# Autodesk Inventor assembly: Anschweißlasche
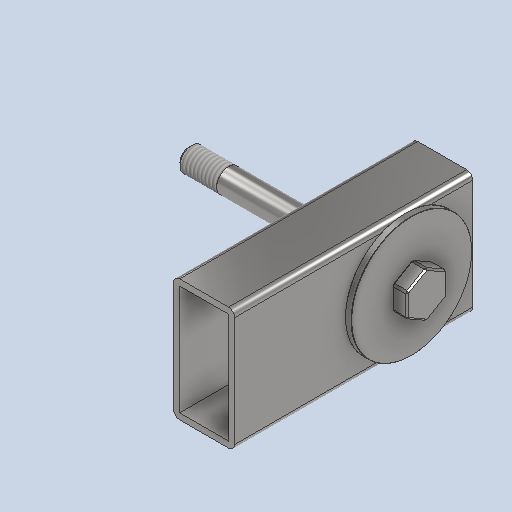
[picture p0: Inventor's stored thumbnail of the model, 512x512]
Saved by Autodesk Inventor 2026.2 (Build 302298010, 298A)
## iProperties
Created: 2026-07-28
Part Number: Anschweißlasche
Document SubType Name: Assembly
Designer: moest
Author: moest
## Documents named in this file (4)
- C:\Users\moest\Downloads\Anschweißlasche.iam
- C:\Users\moest\Downloads\Anschweißlasche Schraube M8.ipt
- C:\Users\moest\Downloads\Anschweißlasche.ipt
- C:\Users\moest\Downloads\Anschweißlasche Scheibe.ipt
## Components (3 placed, 3 different names)
1. Anschweißlasche Schraube M8:1 — Passend:3, Passend:4
2. Anschweißlasche:1 — Passend:1, Passend:2, Passend:3
3. Anschweißlasche Scheibe:1 — Passend:1, Passend:2, Passend:4
## Relationships (4: Mate 4)
- Passend:1 [Mate]: Anschweißlasche:1 ↔ Anschweißlasche Scheibe:1
- Passend:2 [Mate]: Anschweißlasche:1 ↔ Anschweißlasche Scheibe:1
- Passend:3 [Mate]: Anschweißlasche Schraube M8:1 ↔ Anschweißlasche:1
- Passend:4 [Mate]: Anschweißlasche Schraube M8:1 ↔ Anschweißlasche Scheibe:1
